# Autodesk Inventor assembly: Samenstelling
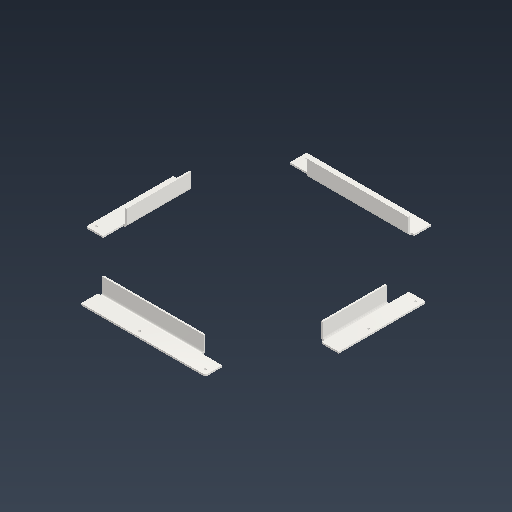
[picture p0: Inventor's stored thumbnail of the model, 512x512]
Saved by Autodesk Inventor 2025.5 (Build 295498000, 498)
## iProperties
RuleStatus: InUse
Created: 2026-10-08
Part Number: Samenstelling
Material: Steel
Document SubType Name: Assembly
Designer: Jasper Kusters
Mass: 4435.88 g
Surface Area: 2434.6 cm^2
Volume: 565.08 cm^3
Density: 7.85 g/cm^3
Description: .
IsahPrimKey: Samenstelling
IsahTableId: 12
Titel: =<Titel Isah>
Titel Isah: .
Tekenaar: Jasper Kusters
Bestelcode: Maakdeel
Type: NORM
Author: Jasper Kusters
Title: .
## Documents named in this file (3)
- L:\CAD_Conf2025\Inventor 2025\Design Data\iLogic\Flenzen\V2\ilogic\Samenstelling.iam
- C:\Vault Workspace\Inventor\CONCEPT\Flenzen\tests\HoekInY_600_50_50_10.ipt
- C:\Vault Workspace\Inventor\CONCEPT\Flenzen\tests\HoekInX_575_50_50_10.ipt
## Components (4 placed, 4 different names)
1. HoekInX — Mate:4, Mate:5, Flush:1
2. HoekInY — Mate:9, Flush:2, Flush:3
3. HoekInX_575_50_50_10:2
4. HoekInY_600_50_50_10:2
## Component patterns: (2 elements, first: HoekInX + HoekInY)
## Relationships (6: Mate 3, Flush 3)
- Mate:4: HoekInX
- Mate:5: HoekInX
- Flush:1 (300 mm): HoekInX
- Mate:9: HoekInY
- Flush:2: HoekInY
- Flush:3 (287.5 mm): HoekInY
## Named parameters: InputLengte = 600 mm, InputBreedte = 575 mm, InputFlensHoogte = 50 mm, InputFlensBreedte = 50 mm, InputGatAfstandLengte = 80 mm, InputAantalGatenLengte = 8, InputGatDia = 10 mm, InputAantalGatenBreedte = 8, InputGatAfstandBreedte = 60 mm, InputBestandsnaam = 1
